# Autodesk Inventor assembly: test_link
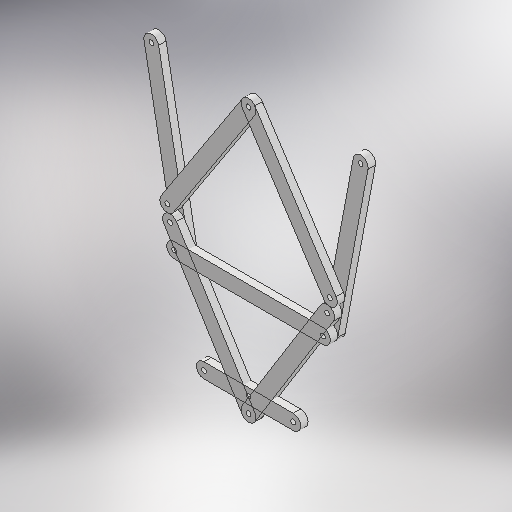
[picture p0: Inventor's stored thumbnail of the model, 512x512]
Saved by Autodesk Inventor 2025.3 (Build 293356030, 356C)
## iProperties
Created: 2026-05-21
Part Number: test_link
Document SubType Name: Assembly
Designer: ibuki_ono
Author: ibuki_ono
## Documents named in this file (4)
- C:\Users\ibuki_ono\Documents\hobby\rogiken\catchrobo\2026_CAD\Hardware_2026\Inventor\End-Effector\pararel\test_link.iam
- C:\Users\ibuki_ono\Documents\hobby\rogiken\catchrobo\2026_CAD\Hardware_2026\Inventor\End-Effector\pararel\3D_link1.ipt
- C:\Users\ibuki_ono\Documents\hobby\rogiken\catchrobo\2026_CAD\Hardware_2026\Inventor\End-Effector\pararel\3D_link2.ipt
- C:\Users\ibuki_ono\Documents\hobby\rogiken\catchrobo\2026_CAD\Hardware_2026\Inventor\End-Effector\pararel\3D_link3.ipt
## Components (8 placed, 3 different names)
1. 3D_link2:1 — メイト:2, フラッシュ:1, フラッシュ:2, フラッシュ:4, メイト:5
2. 3D_link3:1 — メイト:4, フラッシュ:4, メイト:5, 挿入:3, 挿入:6
3. 3D_link1:3 — 挿入:3, 挿入:4, 挿入:7
4. 3D_link3:2 — 挿入:4, メイト:6, メイト:7
5. 3D_link1:4 — 挿入:6, 挿入:8
6. 3D_link3:3 — メイト:7
7. 3D_link3:4 — 挿入:7, メイト:8, メイト:9
8. 3D_link3:5 — 挿入:8, メイト:9
## Relationships (16: Mate 7, Insert 6, Flush 3)
- メイト:2 [Mate]: 3D_link2:1
- フラッシュ:1 [Flush]: 3D_link2:1
- フラッシュ:2 [Flush]: 3D_link2:1
- メイト:4 [Mate]: 3D_link3:1
- フラッシュ:4 [Flush]: 3D_link2:1 ↔ 3D_link3:1
- メイト:5 [Mate] (50 mm): 3D_link2:1 ↔ 3D_link3:1
- 挿入:3 [Insert]: 3D_link3:1 ↔ 3D_link1:3
- 挿入:4 [Insert]: 3D_link1:3 ↔ 3D_link3:2
- メイト:6 [Mate]: 3D_link3:2
- [Insert]: 3D_link1:4 ↔ 3D_link3:3
- 挿入:6 [Insert]: 3D_link3:1 ↔ 3D_link1:4
- メイト:7 [Mate]: 3D_link3:2 ↔ 3D_link3:3
- 挿入:7 [Insert]: 3D_link1:3 ↔ 3D_link3:4
- メイト:8 [Mate]: 3D_link3:4
- 挿入:8 [Insert]: 3D_link1:4 ↔ 3D_link3:5
- メイト:9 [Mate]: 3D_link3:4 ↔ 3D_link3:5
## Named parameters: d17_d15 = 0 mm
